# Autodesk Inventor assembly: Frontal_Puertos
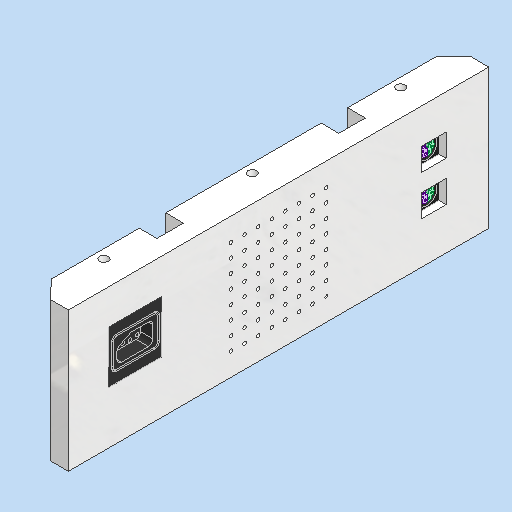
[picture p0: Inventor's stored thumbnail of the model, 512x512]
Saved by Autodesk Inventor 2027 (Build 310192000, 192)
## iProperties
Created: 2026-11-03
Part Number: Frontal_Puertos
Document SubType Name: Assembly
Designer: alex
Author: alex
## Documents named in this file (5)
- C:\Users\alex\Documents\BocetoDigital\ArmadoConsola\Frontal_Puertos.iam
- C:\Users\alex\Documents\BocetoDigital\ArmadoConsola\Pared_puertos.ipt
- C:\Users\alex\Documents\BocetoDigital\ArmadoConsola\PS2.ipt
- C:\Users\alex\Documents\BocetoDigital\ArmadoConsola\Puerto_Unitario_Nes.ipt
- C:\Users\alex\Documents\BocetoDigital\ArmadoConsola\Bafle.ipt
## Components (5 placed, 4 different names)
1. Pared_puertos:1 — Insertar:1, Insertar:2, Insertar:3, Insertar:4, Insertar:5
2. PS2:1 — Insertar:3
3. Puerto_Unitario_Nes:1 — Insertar:1, Insertar:2
4. PS2:2 — Insertar:4
5. Bafle:1 — Insertar:5
## Relationships (5: Insert 5)
- Insertar:1: Pared_puertos:1 ↔ Puerto_Unitario_Nes:1
- Insertar:2: Pared_puertos:1 ↔ Puerto_Unitario_Nes:1
- Insertar:3: Pared_puertos:1 ↔ PS2:1
- Insertar:4: Pared_puertos:1 ↔ PS2:2
- Insertar:5: Pared_puertos:1 ↔ Bafle:1
